# Autodesk Inventor assembly: arm_with_wirst_mount_d405
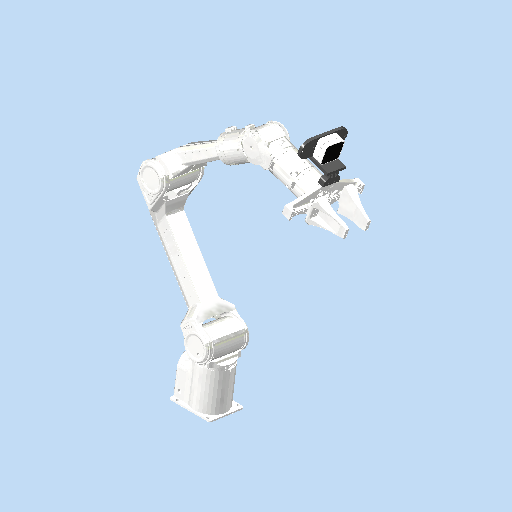
[picture p0: Inventor's stored thumbnail of the model, 512x512]
Saved by Autodesk Inventor 2026.2 (Build 302298000, 298)
## iProperties
Created: 2026-05-28
Part Number: arm_with_wirst_mount_d405
Document SubType Name: Assembly
Designer: teuku
Author: teuku
## Documents named in this file (5)
- C:\Users\teuku\Documents\kubota_lab\moonshot_demo\2026_06\ranger_mini_3\arm_with_wirst_mount_d405.iam
- C:\Users\teuku\Documents\kubota_lab\moonshot_demo\2026_06\ranger_mini_3\piper_factor_1000.0.ipt
- C:\Users\teuku\Documents\kubota_lab\moonshot_demo\2025_11\3d_design_arm_camera\realsense_d405_mounting_bot.ipt
- C:\Users\teuku\Documents\kubota_lab\moonshot_demo\2025_11\3d_design_arm_camera\realsense_d405_mounting_top.ipt
- C:\Users\teuku\Documents\kubota_lab\moonshot_demo\2025_11\3d_design_arm_camera\RealSense_D405\RealSense_D405\RealSense_D405.ipt
## Components (4 placed, 4 different names)
1. piper_factor_1000.0:1 — Mate:70, Mate:71, Insert:1, Mate:72
2. realsense_d405_mounting_bot:1 — Mate:70, Mate:71, Insert:1, Insert:2
3. realsense_d405_mounting_top:1 — Insert:2, Mate:72, Insert:3
4. RealSense_D405:1 — Insert:3
## Relationships (6: Mate 3, Insert 3)
- Mate:70: piper_factor_1000.0:1 ↔ realsense_d405_mounting_bot:1
- Mate:71: piper_factor_1000.0:1 ↔ realsense_d405_mounting_bot:1
- Insert:1: piper_factor_1000.0:1 ↔ realsense_d405_mounting_bot:1
- Insert:2: realsense_d405_mounting_bot:1 ↔ realsense_d405_mounting_top:1
- Mate:72: piper_factor_1000.0:1 ↔ realsense_d405_mounting_top:1
- Insert:3: realsense_d405_mounting_top:1 ↔ RealSense_D405:1
